# Autodesk Inventor assembly: dau_robot
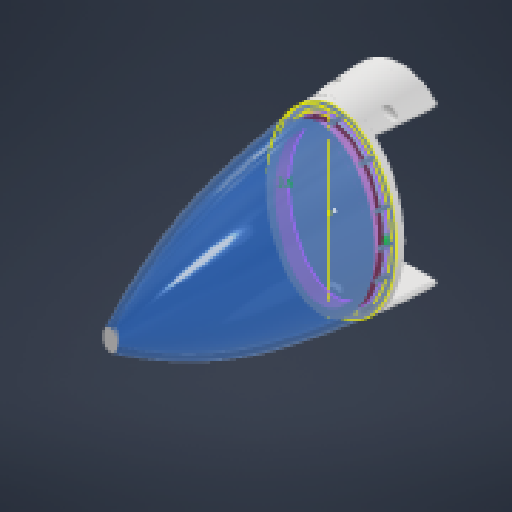
[picture p0: Inventor's stored thumbnail of the model, 512x512]
Saved by Autodesk Inventor 2027 (Build 310192060, 192F)
## iProperties
Created: 2026-08-27
Part Number: dau_robot
Document SubType Name: Assembly
Designer: thita
Author: thita
## Documents named in this file (5)
- C:\Users\thita\ROBOT CÁ\ROBOTFISH_FINAL3\FULL_FISH\Workgroups\NotInProject\dau_robot.iam
- C:\Users\thita\ROBOT CÁ\ROBOTFISH_FINAL3\FULL_FISH\Workgroups\NotInProject\manh_nap_tren.ipt
- C:\Users\thita\ROBOT CÁ\ROBOTFISH_FINAL3\FULL_FISH\Workgroups\NotInProject\manh_nap_duoi.ipt
- C:\Users\thita\ROBOT CÁ\ROBOTFISH_FINAL3\FULL_FISH\Workgroups\NotInProject\nap_dau_ca1.ipt
- C:\Users\thita\Downloads\head only\Workgroups\NotInProject\head.ipt
## Components (4 placed, 4 different names)
1. manh_nap_tren:1
2. manh_nap_duoi:1
3. nap_dau_ca1:1 — Rigid:1
4. head:2 — Rigid:1
## Relationships (1: WeldJoint 1)
- Rigid:1 [WeldJoint]: nap_dau_ca1:1 ↔ head:2
